# Autodesk Inventor assembly: Deska spoje
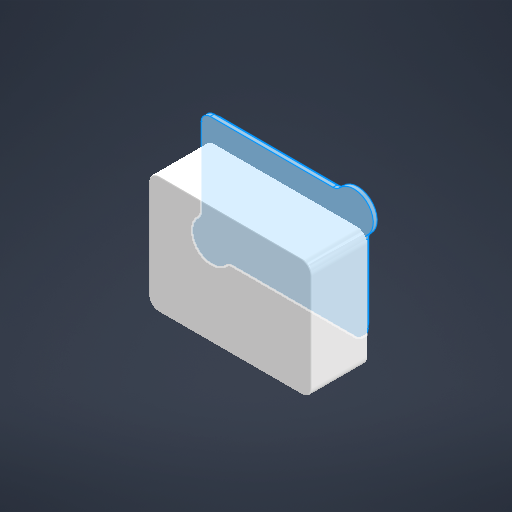
[picture p0: Inventor's stored thumbnail of the model, 512x512]
Saved by Autodesk Inventor 2026.2 (Build 302298000, 298)
## iProperties
Created: 2025-09-30
Part Number: Deska spoje
Document SubType Name: Assembly
Designer: zak
Author: zak
## Documents named in this file (6)
- C:\Users\podpl\Desktop\MRDKY\škola\Inventor\PLOŠNÝ SPOJ\Deska spoje.iam
- C:\Users\podpl\Desktop\MRDKY\škola\Inventor\PLOŠNÝ SPOJ\Deska spoje.ipt
- C:\Users\podpl\Desktop\MRDKY\škola\Inventor\PLOŠNÝ SPOJ\Obal součástí.ipt
- C:\Users\podpl\Desktop\MRDKY\škola\Inventor\PLOŠNÝ SPOJ\CSN 02 1131 - M3 x 6A.ipt
- C:\Users\podpl\Desktop\MRDKY\škola\Inventor\PLOŠNÝ SPOJ\Dno_krabice.ipt
- C:\Users\podpl\Desktop\MRDKY\škola\Inventor\PLOŠNÝ SPOJ\víko součásti.ipt
## Components (8 placed, 5 different names)
1. Deska spoje:1 — Proti sobě:1, Proti sobě:2, Proti sobě:3, Proti sobě:4, Proti sobě:5, Stejný směr:1, Vložit:1, Vložit:2, Vložit:3, Vložit:4, Proti sobě:9
2. Obal součástí:1 — Proti sobě:1, Proti sobě:2, Proti sobě:3
3. CSN 02 1131 - M3 x 6A:1 — Vložit:2
4. CSN 02 1131 - M3 x 6A:2 — Vložit:1, Proti sobě:10
5. CSN 02 1131 - M3 x 6A:3 — Vložit:3
6. CSN 02 1131 - M3 x 6A:4 — Vložit:4
7. Dno_krabice:1 — Proti sobě:7, Proti sobě:9, Proti sobě:10
8. víko součásti:1
## Relationships (13: Mate 8, Insert 4, Flush 1)
- Proti sobě:1 [Mate]: Deska spoje:1 ↔ Obal součástí:1
- Proti sobě:2 [Mate]: Deska spoje:1 ↔ Obal součástí:1
- Proti sobě:3 [Mate]: Deska spoje:1 ↔ Obal součástí:1
- Proti sobě:4 [Mate]: Deska spoje:1
- Proti sobě:5 [Mate]: Deska spoje:1
- Stejný směr:1 [Flush]: Deska spoje:1
- Vložit:1 [Insert]: Deska spoje:1 ↔ CSN 02 1131 - M3 x 6A:2
- Vložit:2 [Insert]: Deska spoje:1 ↔ CSN 02 1131 - M3 x 6A:1
- Vložit:3 [Insert]: Deska spoje:1 ↔ CSN 02 1131 - M3 x 6A:3
- Vložit:4 [Insert]: Deska spoje:1 ↔ CSN 02 1131 - M3 x 6A:4
- Proti sobě:7 [Mate]: Dno_krabice:1
- Proti sobě:9 [Mate]: Deska spoje:1 ↔ Dno_krabice:1
- Proti sobě:10 [Mate]: CSN 02 1131 - M3 x 6A:2 ↔ Dno_krabice:1
